# Autodesk Inventor assembly: MM0886AN110_G39_510
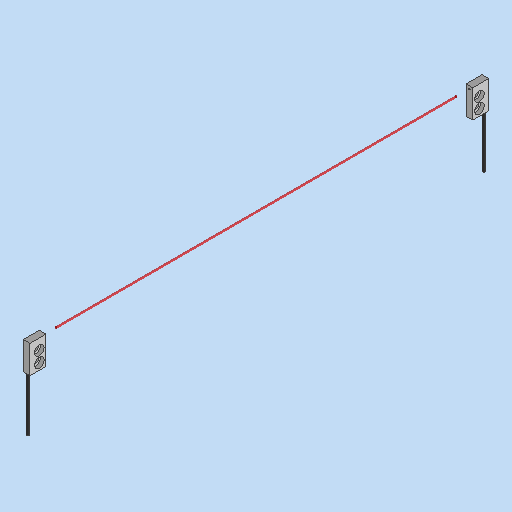
[picture p0: Inventor's stored thumbnail of the model, 512x512]
Saved by Autodesk Inventor 2023.3 (Build 273359000, 359)
## iProperties
RuleStatus: InUse
Created: 2021-07-09
Part Number: MM0886AN110_G39_510
Project: 0850
Description: =<RBPARTNOTITLE2>
Document SubType Name: Assembly
Designer: FH/Da
Mass: 0.273996 g
Surface Area: 6.7734 cm^2
Volume: 0.273996 cm^3
Density: 1 g/cm^3
Vendor: Keyence
AnP_Kategorie: 2
AnP_Material: =<Material>
AnP_TemplVers: 20200821
RBDOCUMENTTYPE: DRF
RBDOCUMENTVERSION: 00
RBDRAWINGMAINSCALE: 1:1
RBDRAWINGMISSINGSPEC: --
RBDRAWINGVOLUME: --
RBDSV1: 0850
RBGBEDGESIN1: +0,5
RBGBEDGESIN2: +0,2
RBGBEDGESOUT1: -0,3
RBGBEDGESOUT2: -0,1
RBGBREMARKSINDEX: E
RBMATERIAL: =<Material>
RBMATMEETS: --
RBMATNO: =<Part Number>
RBPARTMADEOF: FU-57TE
RBPARTNO: SIEHE MNR
RBPARTNOTITLE1: Light barrier transceiver
RBPARTNOTITLE2: Lichtschranke Sender Empfänger
RBPARTSAFETYINDICATOR: --
RBSURFACE: --
RBSURFACE2: --
RBZEDGESNORM: ISO13715:2002-06
RBZGENDIMCLASS: m
RBZGENDIMNORM: ISO 2768-1:1989-11
RBZGENGEOCLASS: H
RBZGENGEONORM: ISO 2768-2:1989-11
RBZSURFACENORM: ISO13D2:2002-02
RBZTOLERANCENORM: ISO 14405-1:2010-12
Name: MM0886AN110_G39_510.iam
Author: FH/Da
Keywords: =<RBPARTMADEOF>
Comments: =<RBSURFACE2>
Revision Number: 01
## Documents named in this file (4)
- C:\Users\rea9an\Documents\Inventor\TCAI2412_te1910_EM\AS00000905.iam
- C:\Users\rea9an\Documents\Inventor\TCAI2412_te1910_EM\PT00004534.ipt
- C:\Users\rea9an\Documents\Inventor\TCAI2412_te1910_EM\PT00004532.ipt
- C:\Users\rea9an\Documents\Inventor\TCAI2412_te1910_EM\PT00004533.ipt
## Components (3 placed, 3 different names)
1. PT00004534:1 — Fluchtend:1, Fluchtend:2, Passend:1
2. PT00004532:1 — Fluchtend:3, Fluchtend:4, Symmetrie:1, Passend:2
3. PT00004533:1 — Fluchtend:5, Fluchtend:6, Symmetrie:1
## Relationships (9: Flush 6, Mate 2, Symmetry 1)
- Fluchtend:1 [Flush]: PT00004534:1
- Fluchtend:2 [Flush]: PT00004534:1
- Passend:1 [Mate]: PT00004534:1
- Fluchtend:3 [Flush]: PT00004532:1
- Fluchtend:4 [Flush]: PT00004532:1
- Fluchtend:5 [Flush]: PT00004533:1
- Fluchtend:6 [Flush]: PT00004533:1
- Symmetrie:1: PT00004532:1 ↔ PT00004533:1
- Passend:2 [Mate] (80 mm): PT00004532:1
